# Autodesk Inventor assembly: Assembly1
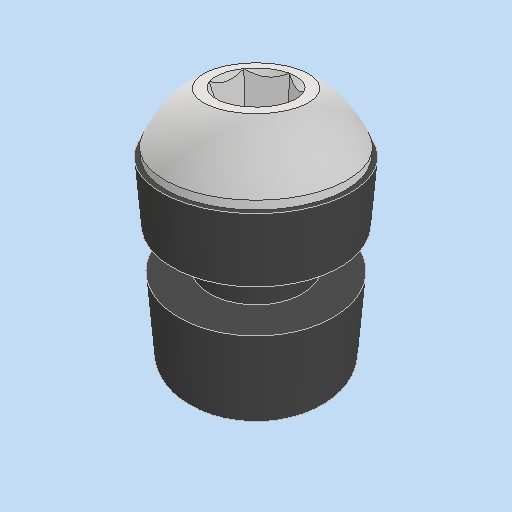
[picture p0: Inventor's stored thumbnail of the model, 512x512]
Saved by Autodesk Inventor 2026 (Build 300175000, 175)
## iProperties
Created: 2026-10-09
Part Number: Assembly1
Document SubType Name: Assembly
Designer: Pacman Ng
Author: Pacman Ng
## Documents named in this file (3)
- D:\OneDrive_MSFT\Work\Drone_Research\3d_models\Calib_base\Assembly1.iam
- D:\OneDrive_MSFT\Work\Drone_Research\3d_models\Calib_base\Hex_M3x8mm.ipt
- D:\OneDrive_MSFT\Work\Drone_Research\3d_models\Calib_base\Antivibration_ball.ipt
## Components (2 placed, 2 different names)
1. Hex_M3x8mm:1 — Mate:1, Mate:2
2. Antivibration_ball:1 — Mate:1, Mate:2
## Relationships (2: Mate 2)
- Mate:1: Hex_M3x8mm:1 ↔ Antivibration_ball:1
- Mate:2: Hex_M3x8mm:1 ↔ Antivibration_ball:1
